# Autodesk Inventor assembly: ESAMBLAJECOMPLETO
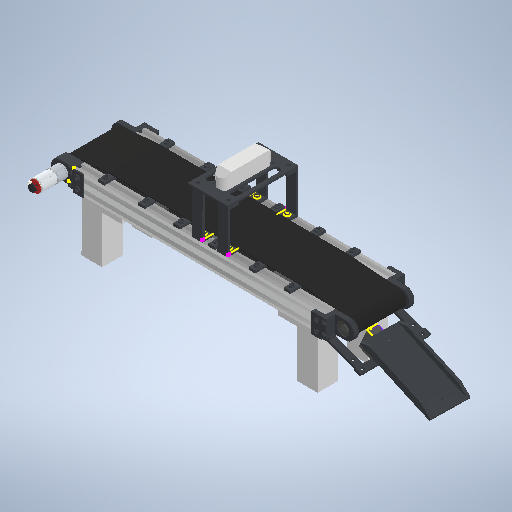
[picture p0: Inventor's stored thumbnail of the model, 512x512]
Saved by Autodesk Inventor 2025.3 (Build 293356000, 356)
## iProperties
Created: 2026-11-27
Part Number: ESAMBLAJECOMPLETO
Document SubType Name: Assembly
Designer: STEVEN LONDOÑO
Author: STEVEN LONDOÑO
## Documents named in this file (3)
- C:\Users\STEVEN LONDOÑO\Documents\BANDA TRANSPORTADORA TERMINADA\BANDA TRANSPORTADORA VALIDACION MECANICA V2\ESAMBLAJECOMPLETO_VALIDADO_SIMULACION_V2.iam
- C:\Users\STEVEN LONDOÑO\Documents\BANDA TRANSPORTADORA TERMINADA\BANDA TRANSPORTADORA VALIDACION MECANICA V2\BANDA_TRANSPORTADORA_PLA_SBR_FINAL.iam
- C:\Users\STEVEN LONDOÑO\Documents\BANDA TRANSPORTADORA TERMINADA\BANDA TRANSPORTADORA VALIDACION MECANICA V2\Motorreductor.iam
## Components (2 placed, 2 different names)
1. BANDA_TRANSPORTADORA_PLA_SBR_FINAL:1 [sub-assembly] — Cilíndrica:1, Coincidencia:1, Acople directo D4 y rodillo 1 a 1, Fase fija del acople directo D4 1 a 1
2. Motorreductor:1 [sub-assembly] — Cilíndrica:1, Coincidencia:1, Carcasa_JGA_1, Carcasa_JGA_2, Carcasa_centrada_JGA_1, Carcasa_centrada_JGA_2, Acople directo D4 y rodillo 1 a 1, Fase fija del acople directo D4 1 a 1
## Relationships (8: Flush 4, CylindricalJoint 1, Mate 1, RelateRotation 1, Angle 1)
- Cilíndrica:1 [CylindricalJoint]: BANDA_TRANSPORTADORA_PLA_SBR_FINAL:1 ↔ Motorreductor:1
- Coincidencia:1 [Mate]: BANDA_TRANSPORTADORA_PLA_SBR_FINAL:1 ↔ Motorreductor:1
- Carcasa_JGA_1 [Flush]: Motorreductor:1
- Carcasa_JGA_2 [Flush]: Motorreductor:1
- Carcasa_centrada_JGA_1 [Flush]: Motorreductor:1
- Carcasa_centrada_JGA_2 [Flush]: Motorreductor:1
- Acople directo D4 y rodillo 1 a 1 [RelateRotation] (1 ul): BANDA_TRANSPORTADORA_PLA_SBR_FINAL:1 ↔ Motorreductor:1
- Fase fija del acople directo D4 1 a 1 [Angle] (90 deg): BANDA_TRANSPORTADORA_PLA_SBR_FINAL:1 ↔ Motorreductor:1
